# Autodesk Inventor assembly: LFA Fit Check
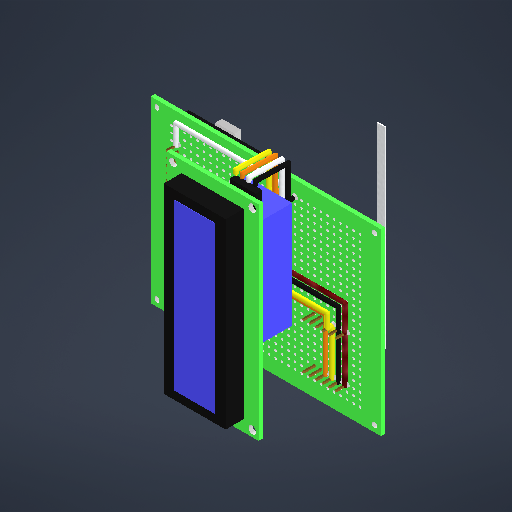
[picture p0: Inventor's stored thumbnail of the model, 512x512]
Saved by Autodesk Inventor 2027.2 (Build 312334000, 334)
## iProperties
Created: 2026-11-11
Part Number: LFA Fit Check
Description: Fit check: LFA strip sliding under the TCS3448 and AS7343
Document SubType Name: Assembly
Designer: isaac
Author: isaac
## Documents named in this file (3)
- C:\Users\isaac\Optical-Sensing-Device\hardware\enclosure\LFA Fit Check.iam
- C:\Users\isaac\Optical-Sensing-Device\hardware\enclosure\Electronics Assembly.iam
- C:\Users\isaac\Optical-Sensing-Device\hardware\enclosure\Test Strips\LFA Strip (bare).ipt
## Components (2 placed, 2 different names)
1. Electronics Assembly:1 [sub-assembly]
2. LFA Strip (bare):1 — Strip on floor, Strip centred, Strip insertion
## Relationships (3: Flush 2, Mate 1)
- Strip on floor [Flush]: LFA Strip (bare):1
- Strip centred [Mate]: LFA Strip (bare):1
- Strip insertion [Flush]: LFA Strip (bare):1
## Named parameters: StripInsertion = 0 mm, StripInsertionMin = 0 mm, StripInsertionMax = 80 mm
